# Autodesk Inventor assembly: Ensamble_final
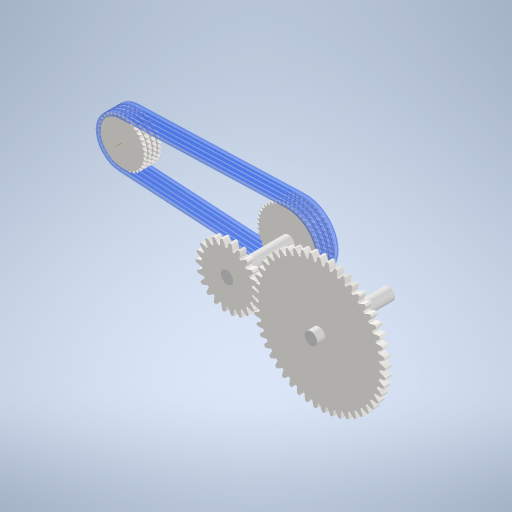
[picture p0: Inventor's stored thumbnail of the model, 512x512]
Saved by Autodesk Inventor 2024 (Build 280153000, 153)
## iProperties
Created: 2024-09-19
Part Number: Ensamble_final
Document SubType Name: Assembly
Designer: aulac205
Author: aulac205
## Documents named in this file (5)
- C:\Users\aulac205\Documents\Inventor\Ensamble_final.iam
- C:\Users\aulac205\Documents\Inventor\Cadena.iam
- C:\Users\aulac205\Documents\Inventor\Eje.ipt
- C:\Users\aulac205\Documents\Inventor\Piñon.ipt
- C:\Users\aulac205\Documents\Inventor\Rueda.ipt
## Components (5 placed, 4 different names)
1. Cadena:1 [sub-assembly] — De rotación:1, Rotación:1
2. Eje:1 — Coincidencia:1, De rotación:3
3. Eje:2 — De rotación:1, De rotación:2, Coincidencia:1
4. Engranaje recto1:1 — De rotación:2, Rotación:1, Rotación:2
5. Engranaje recto2:1 — De rotación:3, Rotación:2
## Relationships (6: RevoluteJoint 3, RelateRotation 2, Mate 1)
- De rotación:1 [RevoluteJoint]: Cadena:1 ↔ Eje:2
- De rotación:2 [RevoluteJoint]: Eje:2 ↔ Engranaje recto1:1
- Rotación:1 [RelateRotation] (1 ul): Cadena:1 ↔ Engranaje recto1:1
- Coincidencia:1 [Mate] (284.444 mm): Eje:1 ↔ Eje:2
- De rotación:3 [RevoluteJoint] (-25 mm): Eje:1 ↔ Engranaje recto2:1
- Rotación:2 [RelateRotation] (2 ul): Engranaje recto1:1 ↔ Engranaje recto2:1
